# Autodesk Inventor assembly: Scharnier
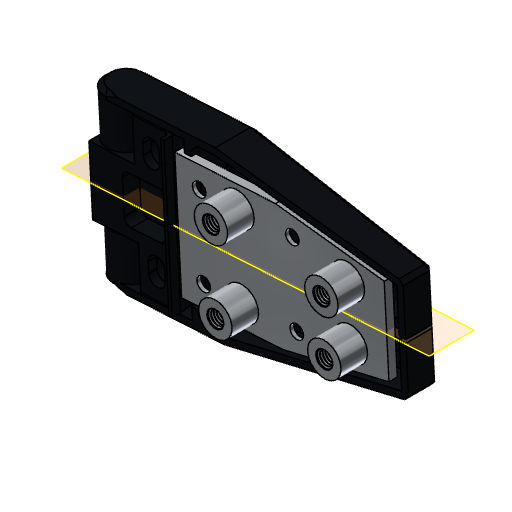
[picture p0: Inventor's stored thumbnail of the model, 512x512]
Saved by Autodesk Inventor 2024.3 (Build 283343000, 343)
## iProperties
Created: 2018-05-07
Part Number: Scharnier
Material: Generisch
Document SubType Name: Assembly
Designer: MK
Mass: 220.911 g
Surface Area: 278.195 cm^2
Volume: 30.8967 cm^3
Density: 7.15 g/cm^3
Bemerkung: Lager
Author: MK
## Documents named in this file (5)
- C:\Users\la\Documents\GitHub\Inventor_Sizer\C# Version\MODELS\Scharnier.iam
- C:\Users\la\Documents\GitHub\Inventor_Sizer\C# Version\MODELS\Scharnier Teil1.ipt
- C:\Users\la\Documents\GitHub\Inventor_Sizer\C# Version\MODELS\Scharnier Teil4.ipt
- C:\Users\la\Documents\GitHub\Inventor_Sizer\C# Version\MODELS\Scharnier Teil2.ipt
- C:\Users\la\Documents\GitHub\Inventor_Sizer\C# Version\MODELS\Scharnier Teil3.ipt
## Components (4 placed, 4 different names)
1. Scharnier Teil3:1 — Mate:7, Mate:8, Flush:1, Mate:12, Symmetry:1
2. Scharnier Teil2:1 — Flush:1, Mate:9, Mate:10, Mate:11, Symmetry:1
3. Scharnier Teil4:1 — Mate:7, Mate:8, Mate:9
4. Scharnier Teil1:1 — Mate:10, Mate:11, Mate:12
## Relationships (8: Mate 6, Flush 1, Symmetry 1)
- Mate:7: Scharnier Teil3:1 ↔ Scharnier Teil4:1
- Mate:8: Scharnier Teil3:1 ↔ Scharnier Teil4:1
- Flush:1: Scharnier Teil3:1 ↔ Scharnier Teil2:1
- Mate:9: Scharnier Teil2:1 ↔ Scharnier Teil4:1
- Mate:10: Scharnier Teil2:1 ↔ Scharnier Teil1:1
- Mate:11: Scharnier Teil2:1 ↔ Scharnier Teil1:1
- Mate:12: Scharnier Teil3:1 ↔ Scharnier Teil1:1
- Symmetry:1: Scharnier Teil3:1 ↔ Scharnier Teil2:1
